# Autodesk Inventor assembly: MM0948AN120_G10_001
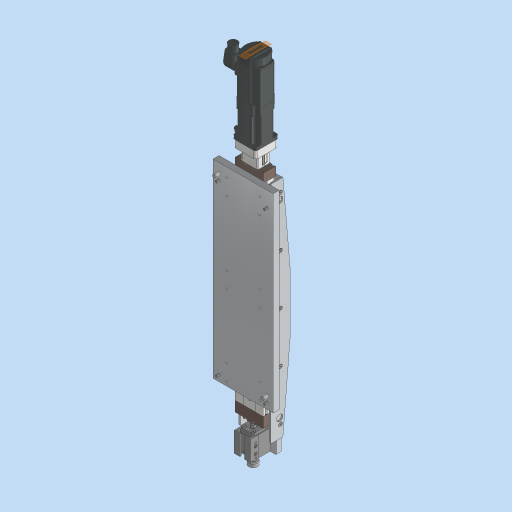
[picture p0: Inventor's stored thumbnail of the model, 512x512]
Saved by Autodesk Inventor 2023.3 (Build 273359000, 359)
## iProperties
Part Number: MM0948AN120_G10_001
Material: Generisch
Description: =<RBPARTNOTITLE2>
Document SubType Name: Assembly
Designer: FH/Wi
Mass: 6805.2 g
Surface Area: 7676.74 cm^2
Volume: 3087.36 cm^3
Density: 2.20421 g/cm^3
Created: 2023-03-23
RBCHANGEDESCRIPTION1: Erstfreigabe
RBCHANGENO1: 00
RBDOCUMENTTYPE: DRF
RBDOCUMENTVERSION: 00
RBDRAWINGMAINSCALE: 1:1
RBDRAWINGMISSINGSPEC: --
RBDRAWINGVOLUME: --
RBDSV1: 0850
RBGBDETAILS: 43274
RBGBEDGESIN1: +0,5
RBGBEDGESIN2: +0,2
RBGBEDGESOUT1: -0,3
RBGBEDGESOUT2: -0,1
RBMATERIAL: =<Material>
RBMATMEETS: --
RBMATNO: =<Part Number>
RBORGUNITRESPONSIBLE1: AnP/TEF1
RBPARTMADEOF: --
RBPARTNO: SIEHE MNR
RBPARTNOTITLE1: tool change axis
RBPARTNOTITLE2: Rüstachse
RBPARTSAFETYINDICATOR: --
RBSURFACE: --
RBSURFACE2: --
RBZEDGESNORM: ISO13715:2002-06
RBZGENDIMCLASS: m
RBZGENDIMNORM: ISO 2768-1:1989-11
RBZGENGEOCLASS: H
RBZGENGEONORM: ISO 2768-2:1989-11
RBZSURFACENORM: ISO13D2:2002-02
RBZTOLERANCENORM: ISO 14405-1:2010-12
AnP_Kommentar: --
MaxAbmaße: --
AnP_TemplVers: 20190222
AnP_Kategorie: 99
AnP_Material: =<Material>
Author: FH/Wi
Keywords: =<RBPARTMADEOF>
Comments: =<RBSURFACE2>
Revision Number: 01
## Documents named in this file (30)
- C:\Users\rea9an\Documents\Inventor\TCAI2412_te1910_EM\AS00000946.iam
- C:\Users\rea9an\Documents\Inventor\TCAI2412_te1910_EM\PT00004876.ipt
- C:\Users\rea9an\Documents\Inventor\TCAI2412_te1910_EM\PT00004494.ipt
- C:\Users\rea9an\Documents\Inventor\TCAI2412_te1910_EM\PT00004877.ipt
- C:\Users\rea9an\Documents\Inventor\TCAI2412_te1910_EM\PT00004790.ipt
- C:\Users\rea9an\Documents\Inventor\TCAI2412_te1910_EM\PT00004858.ipt
- C:\Users\rea9an\Documents\Inventor\TCAI2412_te1910_EM\PT00004904.ipt
- C:\Users\rea9an\Documents\Inventor\TCAI2412_te1910_EM\PT00004887.ipt
- C:\Users\rea9an\Documents\Inventor\TCAI2412_te1910_EM\PT00004514.ipt
- C:\Users\rea9an\Documents\Inventor\TCAI2412_te1910_EM\PT00004911.ipt
- C:\Users\rea9an\Documents\Inventor\TCAI2412_te1910_EM\PT00004633.ipt
- C:\Users\rea9an\Documents\Inventor\TCAI2412_te1910_EM\PT00004824.ipt
- C:\Users\rea9an\Documents\Inventor\TCAI2412_te1910_EM\PT00004634.ipt
- C:\Users\rea9an\Documents\Inventor\TCAI2412_te1910_EM\PT00004635.ipt
- C:\Users\rea9an\Documents\Inventor\TCAI2412_te1910_EM\PT00004637.ipt
- C:\Users\rea9an\Documents\Inventor\TCAI2412_te1910_EM\PT00004638.ipt
- C:\Users\rea9an\Documents\Inventor\TCAI2412_te1910_EM\PT00004632.ipt
- C:\Users\rea9an\Documents\Inventor\TCAI2412_te1910_EM\PT00004639.ipt
- C:\Users\rea9an\Documents\Inventor\TCAI2412_te1910_EM\PT00004894.ipt
- C:\Users\rea9an\Documents\Inventor\TCAI2412_te1910_EM\PT00004832.ipt
- C:\Users\rea9an\Documents\Inventor\TCAI2412_te1910_EM\PT00004636.ipt
- C:\Users\rea9an\Documents\Inventor\TCAI2412_te1910_EM\AS00000945.iam
- C:\Users\rea9an\Documents\Inventor\TCAI2412_te1910_EM\PT00004640.ipt
- C:\Users\rea9an\Documents\Inventor\TCAI2412_te1910_EM\PT00004831.ipt
- C:\Users\rea9an\Documents\Inventor\TCAI2412_te1910_EM\PT00004844.ipt
- C:\Users\rea9an\Documents\Inventor\TCAI2412_te1910_EM\PT00004912.ipt
- C:\Users\rea9an\Documents\Inventor\TCAI2412_te1910_EM\PT00004641.ipt
- C:\Users\rea9an\Documents\Inventor\TCAI2412_te1910_EM\PT00004644.ipt
- C:\Users\rea9an\Documents\Inventor\TCAI2412_te1910_EM\PT00004914.ipt
- C:\_AnPCAD\_AnP_CAD\MM\MM0948AN_DispensenStandardbaugruppen\MM0948AN120_Ruestachse\G10\MM0948AN120_G10_001.iam
## Components (82 placed, 28 different names)
1. PT00004632:1
2. PT00004633:3 — Einfügen:128, HUB, Fluchtend:59, Fluchtend:60, Einfügen:151, Passend:140, Passend:141
3. PT00004634:3 — Einfügen:158
4. PT00004635:3 — Passend:136, Passend:137, Passend:138, Passend:139
5. PT00004636:1 — Fluchtend:59, Fluchtend:60, Einfügen:154, Einfügen:155, Passend:141
6. PT00004637:1 — Passend:23, Passend:24, Passend:25, Passend:27, Passend:28, Passend:29, Passend:31, Einfügen:56, Einfügen:59, Einfügen:60, Passend:93, Einfügen:98, Einfügen:99, Passend:103, Passend:104, Passend:105, Einfügen:130, Einfügen:131, Einfügen:132, Passend:126, Winkel:1
7. PT00004638:1 — Passend:31, Einfügen:109, Passend:94, Einfügen:110, Passend:97, Einfügen:128, Einfügen:133, Einfügen:134, Einfügen:135, Einfügen:136, Einfügen:137, Einfügen:138, Einfügen:139, Einfügen:140, Einfügen:141, Einfügen:142, Passend:127, Passend:128, Tangential:1, Tangential:2, Passend:129, Einfügen:147, Einfügen:148, Passend:131, Einfügen:159, Einfügen:160
8. PT00004639:2 — Einfügen:110, Passend:97, Einfügen:145, Einfügen:146
9. PT00004639:1 — Einfügen:109, Passend:94, Einfügen:143, Einfügen:144
10. PT00004912:4
11. PT00004912:3
12. PT00004912:1
13. PT00004912:2
14. PT00004640:1 — Einfügen:151, Passend:140, Einfügen:156, Einfügen:157
15. PT00004844:1 — Einfügen:154
16. PT00004844:2 — Einfügen:155
17. PT00004844:3 — Einfügen:157
18. PT00004844:4 — Einfügen:156
19. PT00004644:1 — Einfügen:160
20. PT00004644:2 — Einfügen:159
21. PT00004832:10 — Einfügen:145
22. PT00004832:9 — Einfügen:146
23. PT00004832:8 — Einfügen:144
24. PT00004832:7 — Einfügen:143
25. PT00004831:1 — Passend:138
26. PT00004831:3 — Passend:137
27. PT00004831:2 — Passend:139
28. PT00004831:4 — Passend:136
29. PT00004911:2 — Einfügen:142
30. PT00004911:1 — Einfügen:135
31. PT00004832:6
32. PT00004832:5
33. PT00004832:4
34. PT00004832:3
35. PT00004832:2
36. PT00004832:1
37. PT00004904:3 — Einfügen:132
38. PT00004894:1
39. PT00004824:3 — Einfügen:158
40. PT00004887:4 — Einfügen:60
41. PT00004887:3 — Einfügen:59
42. PT00004887:2 — Einfügen:131
43. PT00004887:1 — Einfügen:130
44. PT00004904:2 — Einfügen:56
45. PT00004858:8 — Einfügen:136
46. PT00004858:7 — Einfügen:134
47. PT00004858:6 — Einfügen:137
48. PT00004858:5 — Einfügen:133
49. PT00004858:4 — Einfügen:138
50. PT00004858:3 — Einfügen:139
51. PT00004858:2 — Einfügen:141
52. PT00004858:1 — Einfügen:140
53. PT00004914:1
54. PT00004914:2
55. PT00004877:2
56. PT00004877:3 — Einfügen:147
57. PT00004877:4 — Einfügen:148
58. PT00004877:1
59. PT00004514:2 — Passend:127, Tangential:2
60. PT00004514:1 — Passend:128, Tangential:1
61. AS00000945:1 [sub-assembly] — Passend:93, HUB, Passend:126, Passend:129, Winkel:1, Passend:131
62. PT00004641:1
63. PT00004790:1 — Einfügen:98
64. PT00004790:2 — Einfügen:99
65. PT00004876:1 — Einfügen:14
66. PT00004494:1 — Passend:23, Passend:24, Passend:25, Einfügen:13, Einfügen:14
67. PT00004876:2 — Einfügen:13
68. PT00004876:3
69. PT00004494:4 — Passend:27, Passend:28, Passend:29
70. PT00004876:4
71. PT00004876:5
72. PT00004494:5
73. PT00004876:6
74. PT00004876:7
75. PT00004494:6
76. PT00004876:8
77. PT00004876:9
78. PT00004494:7
79. PT00004876:10
80. PT00004876:11
81. PT00004494:8
82. PT00004876:12
## Component patterns: (3 elements, first: PT00004876:1 + PT00004494:1 + PT00004876:2 + PT00004876:3 + PT00004494:4 + PT00004876:4)
## Relationships (91: Insert 50, Mate 35, Flush 3, Tangent 2, Angle 1)
- HUB [Flush] (72.5 mm): PT00004633:3 ↔ AS00000945:1
- Passend:23 [Mate]: PT00004637:1 ↔ PT00004494:1
- Passend:24 [Mate]: PT00004637:1 ↔ PT00004494:1
- Passend:25 [Mate]: PT00004637:1 ↔ PT00004494:1
- Einfügen:13 [Insert]: PT00004494:1 ↔ PT00004876:2
- Einfügen:14 [Insert]: PT00004876:1 ↔ PT00004494:1
- [Insert]: PT00004494:4 ↔ PT00004876:4
- [Insert]: PT00004876:3 ↔ PT00004494:4
- Passend:27 [Mate]: PT00004637:1 ↔ PT00004494:4
- Passend:28 [Mate]: PT00004637:1 ↔ PT00004494:4
- Passend:29 [Mate]: PT00004637:1 ↔ PT00004494:4
- Passend:31 [Mate]: PT00004637:1 ↔ PT00004638:1
- [Insert]: PT00004638:1 ↔ PT00004877:1
- [Insert]: PT00004638:1 ↔ PT00004877:2
- [Insert]: PT00004638:1 ↔ PT00004914:2
- [Insert]: PT00004638:1 ↔ PT00004914:1
- Einfügen:56 [Insert]: PT00004637:1 ↔ PT00004904:2
- Einfügen:59 [Insert]: PT00004637:1 ↔ PT00004887:3
- Einfügen:60 [Insert]: PT00004637:1 ↔ PT00004887:4
- Passend:93 [Mate]: PT00004637:1 ↔ AS00000945:1
- Einfügen:98 [Insert]: PT00004637:1 ↔ PT00004790:1
- Einfügen:99 [Insert]: PT00004637:1 ↔ PT00004790:2
- Einfügen:109 [Insert]: PT00004638:1 ↔ PT00004639:1
- Passend:94 [Mate]: PT00004638:1 ↔ PT00004639:1
- [Mate]: PT00004639:1 ↔ PT00004832:1
- Einfügen:110 [Insert]: PT00004638:1 ↔ PT00004639:2
- Passend:97 [Mate]: PT00004638:1 ↔ PT00004639:2
- [Mate]: PT00004639:1 ↔ PT00004832:2
- [Mate]: PT00004639:1 ↔ PT00004832:3
- [Mate]: PT00004639:2 ↔ PT00004832:4
- [Mate]: PT00004639:2 ↔ PT00004832:5
- [Mate]: PT00004639:2 ↔ PT00004832:6
- Passend:103 [Mate] (1168 mm): PT00004637:1
- Passend:104 [Mate] (-105 mm): PT00004637:1
- Passend:105 [Mate] (-1015 mm): PT00004637:1
- [Mate]: PT00004633:3 ↔ PT00004641:1
- [Insert]: PT00004633:3 ↔ PT00004635:3
- [Mate]: PT00004633:3 ↔ PT00004635:3
- [Mate]: PT00004634:3 ↔ PT00004635:3
- [Mate]: PT00004632:1 ↔ PT00004633:3
- [Insert]: PT00004632:1 ↔ PT00004634:3
- [Insert]: PT00004632:1 ↔ PT00004894:1
- [Mate]: PT00004633:3 ↔ PT00004641:1
- Einfügen:128 [Insert]: PT00004633:3 ↔ PT00004638:1
- Einfügen:130 [Insert]: PT00004637:1 ↔ PT00004887:1
- Einfügen:131 [Insert]: PT00004637:1 ↔ PT00004887:2
- Einfügen:132 [Insert]: PT00004637:1 ↔ PT00004904:3
- Passend:126 [Mate]: PT00004637:1 ↔ AS00000945:1
- Einfügen:133 [Insert]: PT00004638:1 ↔ PT00004858:5
- Einfügen:134 [Insert]: PT00004638:1 ↔ PT00004858:7
- Einfügen:135 [Insert]: PT00004638:1 ↔ PT00004911:1
- Einfügen:136 [Insert]: PT00004638:1 ↔ PT00004858:8
- Einfügen:137 [Insert]: PT00004638:1 ↔ PT00004858:6
- Einfügen:138 [Insert]: PT00004638:1 ↔ PT00004858:4
- Einfügen:139 [Insert]: PT00004638:1 ↔ PT00004858:3
- Einfügen:140 [Insert]: PT00004638:1 ↔ PT00004858:1
- Einfügen:141 [Insert]: PT00004638:1 ↔ PT00004858:2
- Einfügen:142 [Insert]: PT00004638:1 ↔ PT00004911:2
- Passend:127 [Mate]: PT00004638:1 ↔ PT00004514:2
- Passend:128 [Mate]: PT00004638:1 ↔ PT00004514:1
- Tangential:1: PT00004638:1 ↔ PT00004514:1
- Tangential:2: PT00004638:1 ↔ PT00004514:2
- Passend:129 [Mate]: PT00004638:1 ↔ AS00000945:1
- Winkel:1 [Angle] (0 deg): PT00004637:1 ↔ AS00000945:1
- Einfügen:143 [Insert]: PT00004639:1 ↔ PT00004832:7
- Einfügen:144 [Insert]: PT00004639:1 ↔ PT00004832:8
- Einfügen:145 [Insert]: PT00004639:2 ↔ PT00004832:10
- Einfügen:146 [Insert]: PT00004639:2 ↔ PT00004832:9
- Einfügen:147 [Insert]: PT00004638:1 ↔ PT00004877:3
- Einfügen:148 [Insert]: PT00004638:1 ↔ PT00004877:4
- Fluchtend:59 [Flush]: PT00004633:3 ↔ PT00004636:1
- Fluchtend:60 [Flush]: PT00004633:3 ↔ PT00004636:1
- Passend:131 [Mate]: PT00004638:1 ↔ AS00000945:1
- Passend:136 [Mate]: PT00004635:3 ↔ PT00004831:4
- Passend:137 [Mate]: PT00004635:3 ↔ PT00004831:3
- Passend:138 [Mate]: PT00004635:3 ↔ PT00004831:1
- Passend:139 [Mate]: PT00004635:3 ↔ PT00004831:2
- [Insert]: PT00004636:1 ↔ PT00004912:3
- [Insert]: PT00004636:1 ↔ PT00004912:4
- Einfügen:151 [Insert]: PT00004633:3 ↔ PT00004640:1
- Passend:140 [Mate]: PT00004633:3 ↔ PT00004640:1
- [Insert]: PT00004912:1 ↔ PT00004640:1
- [Insert]: PT00004912:2 ↔ PT00004640:1
- Einfügen:154 [Insert]: PT00004636:1 ↔ PT00004844:1
- Einfügen:155 [Insert]: PT00004636:1 ↔ PT00004844:2
- Einfügen:156 [Insert]: PT00004640:1 ↔ PT00004844:4
- Einfügen:157 [Insert]: PT00004640:1 ↔ PT00004844:3
- Einfügen:158 [Insert]: PT00004634:3 ↔ PT00004824:3
- Passend:141 [Mate]: PT00004633:3 ↔ PT00004636:1
- Einfügen:159 [Insert]: PT00004638:1 ↔ PT00004644:2
- Einfügen:160 [Insert]: PT00004638:1 ↔ PT00004644:1
## Named parameters: d68_d66 = 0 mm, d69_d67 = 0 mm, d360_d353 = 0 mm, d361_d354 = 0 mm, d362_d357 = 0 mm, d363_d340 = 0 mm, d368_d23 = 0 mm
